# Autodesk Inventor assembly: MM0948AN220_G11_001
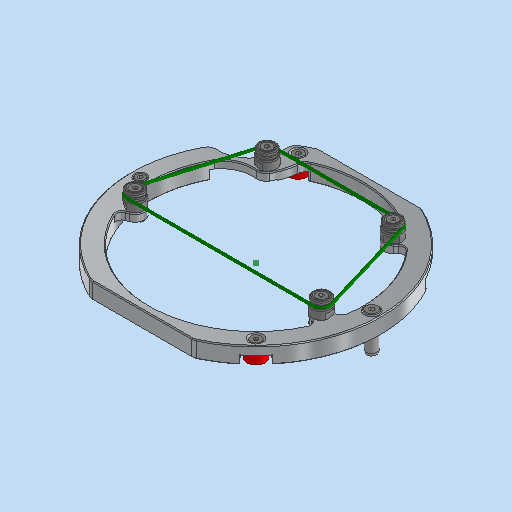
[picture p0: Inventor's stored thumbnail of the model, 512x512]
Saved by Autodesk Inventor 2023.3 (Build 273359000, 359)
## iProperties
Created: 2024-02-23
Part Number: MM0948AN220_G11_001
Description: =<RBPARTNOTITLE2>
Document SubType Name: Assembly
Designer: RIC7AN
Mass: 110.695 g
Surface Area: 205.364 cm^2
Volume: 32.3045 cm^3
Density: 3.4266 g/cm^3
RBPARTMADEOF: --
RBDRAWINGMISSINGSPEC: --
AnP_Kategorie: 99
RBPARTNOTITLE2: O-Ring-Halter
RBSURFACE: --
RBPARTNOTITLE1: O-Ring-mount
AnP_Material: =<Material>
RBMATERIAL: =<Material>
RBMATNO: =<Part Number>
RBPARTNO: SIEHE MNR
MaxAbmaße: 28,7 x 123 x 135 (FM)
Author: RIC7AN
Keywords: =<RBPARTMADEOF>
Comments: =<RBSURFACE2>
Revision Number: 01
## Documents named in this file (11)
- C:\Users\rea9an\Documents\Inventor\TCAI2412_te1910_EM\AS00000972.iam
- C:\Users\rea9an\Documents\Inventor\TCAI2412_te1910_EM\PT00004620.ipt
- C:\Users\rea9an\Documents\Inventor\TCAI2412_te1910_EM\PT00004621.ipt
- C:\Users\rea9an\Documents\Inventor\TCAI2412_te1910_EM\PT00004906.ipt
- C:\Users\rea9an\Documents\Inventor\TCAI2412_te1910_EM\PT00004908.ipt
- C:\Users\rea9an\Documents\Inventor\TCAI2412_te1910_EM\PT00004454.ipt
- C:\Users\rea9an\Documents\Inventor\TCAI2412_te1910_EM\PT00004830.ipt
- C:\Users\rea9an\Documents\Inventor\TCAI2412_te1910_EM\PT00004837.ipt
- C:\Users\rea9an\Documents\Inventor\TCAI2412_te1910_EM\PT00004841.ipt
- C:\Users\rea9an\Documents\Inventor\TCAI2412_te1910_EM\PT00004828.ipt
- C:\Users\rea9an\Documents\Inventor\TCAI2412_te1910_EM\PT00004719.ipt
## Components (18 placed, 10 different names)
1. PT00004620:1 — Einfügen:9, Einfügen:10
2. PT00004621:1
3. PT00004621:2
4. PT00004621:3
5. PT00004621:4
6. PT00004719:1
7. PT00004906:1
8. PT00004908:1
9. PT00004454:1
10. PT00004454:2
11. PT00004830:1
12. PT00004830:2
13. PT00004837:1 — Einfügen:10
14. PT00004841:1 — Einfügen:9
15. PT00004828:1
16. PT00004828:2
17. PT00004828:3
18. PT00004828:4
## Relationships (26: Mate 17, Insert 8, Tangent 1)
- [Mate]: PT00004620:1 ↔ PT00004621:1
- [Mate]: PT00004621:1 ↔ PT00004719:1
- [Tangent]: PT00004621:1 ↔ PT00004719:1
- [Mate]: PT00004620:1 ↔ PT00004906:1
- [Mate]: PT00004620:1 ↔ PT00004906:1
- [Mate]: PT00004620:1 ↔ PT00004908:1
- [Mate]: PT00004620:1 ↔ PT00004908:1
- [Mate]: PT00004620:1 ↔ PT00004454:2
- [Mate]: PT00004620:1 ↔ PT00004454:2
- [Insert]: PT00004620:1 ↔ PT00004830:1
- [Mate]: PT00004620:1 ↔ PT00004454:1
- [Mate]: PT00004620:1 ↔ PT00004454:1
- [Insert]: PT00004620:1 ↔ PT00004830:2
- [Mate]: PT00004620:1 ↔ PT00004621:1
- [Mate]: PT00004620:1 ↔ PT00004621:4
- [Mate]: PT00004620:1 ↔ PT00004621:4
- [Mate]: PT00004620:1 ↔ PT00004621:3
- [Mate]: PT00004620:1 ↔ PT00004621:2
- [Mate]: PT00004620:1 ↔ PT00004621:2
- [Mate]: PT00004620:1 ↔ PT00004621:3
- [Insert]: PT00004621:2 ↔ PT00004828:1
- [Insert]: PT00004621:4 ↔ PT00004828:2
- [Insert]: PT00004621:3 ↔ PT00004828:4
- [Insert]: PT00004621:1 ↔ PT00004828:3
- Einfügen:9 [Insert]: PT00004620:1 ↔ PT00004841:1
- Einfügen:10 [Insert]: PT00004620:1 ↔ PT00004837:1
## Named parameters: d19_d23 = 0 mm
